# Autodesk Inventor assembly: SPE5V1 Guia Detectores
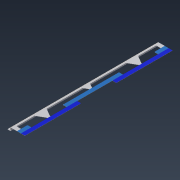
[picture p0: Inventor's stored thumbnail of the model, 180x180]
Saved by Autodesk Inventor 2021.2 (Build 252289000, 289)
## iProperties
Created: 2026-10-13
Part Number: SPE5V1 Guia Detectores
Document SubType Name: Assembly
Designer: nelso
Author: nelso
## Documents named in this file (6)
- C:\Users\Tecnica\OneDrive\Documentos\Mecanica\Soporte-Paciente-Espinografia\Workspace\SPE5V1 Guia Detectores.iam
- C:\Users\Tecnica\OneDrive\Documentos\Mecanica\Soporte-Paciente-Espinografia\Workspace\SP50V1 Chapa Detectores.ipt
- C:\Users\Tecnica\OneDrive\Documentos\Mecanica\Soporte-Paciente-Espinografia\Workspace\SP51V1 Felpa Detectores.ipt
- C:\Users\Tecnica\OneDrive\Documentos\Mecanica\Soporte-Paciente-Espinografia\Workspace\PinturaDetectores.ipt
- C:\Users\Tecnica\OneDrive\Documentos\Mecanica\Soporte-Paciente-Espinografia\Workspace\E1018NEO.ipt
- C:\Users\Tecnica\OneDrive\Documentos\Mecanica\Soporte-Paciente-Espinografia\Workspace\ISO7380M3X0.5L6I.ipt
## Components (9 placed, 5 different names)
1. SP50V1 Chapa Detectores:1 — Mate:1, Flush:1, Flush:2, Mate:2, Mate:3, Mate:4, Flush:6, Mate:6, Mate:7, Mate:8, Mate:9, Mate:10, Mate:11, Mate:12, Mate:13, Mate:14, Mate:15, Mate:16, Mate:17, Mate:18
2. SP51V1 Felpa Detectores:1 — Mate:2, Mate:3, Mate:4
3. PinturaDetectores:1 — Mate:1, Flush:1, Flush:2
4. E1018NEO:1 — Mate:7, Mate:12
5. E1018NEO:2 — Mate:8, Mate:11
6. E1018NEO:3 — Mate:9, Mate:10
7. ISO7380M3X0.5L6I:1 — Mate:13, Mate:14
8. ISO7380M3X0.5L6I:2 — Mate:15, Mate:16
9. ISO7380M3X0.5L6I:3 — Mate:17, Mate:18
## Relationships (20: Mate 17, Flush 3)
- Mate:1: SP50V1 Chapa Detectores:1 ↔ PinturaDetectores:1
- Flush:1: SP50V1 Chapa Detectores:1 ↔ PinturaDetectores:1
- Flush:2: SP50V1 Chapa Detectores:1 ↔ PinturaDetectores:1
- Mate:2: SP50V1 Chapa Detectores:1 ↔ SP51V1 Felpa Detectores:1
- Mate:3: SP50V1 Chapa Detectores:1 ↔ SP51V1 Felpa Detectores:1
- Mate:4 (7 mm): SP50V1 Chapa Detectores:1 ↔ SP51V1 Felpa Detectores:1
- Flush:6: SP50V1 Chapa Detectores:1
- Mate:6: SP50V1 Chapa Detectores:1
- Mate:7: SP50V1 Chapa Detectores:1 ↔ E1018NEO:1
- Mate:8: SP50V1 Chapa Detectores:1 ↔ E1018NEO:2
- Mate:9: SP50V1 Chapa Detectores:1 ↔ E1018NEO:3
- Mate:10: SP50V1 Chapa Detectores:1 ↔ E1018NEO:3
- Mate:11: SP50V1 Chapa Detectores:1 ↔ E1018NEO:2
- Mate:12: SP50V1 Chapa Detectores:1 ↔ E1018NEO:1
- Mate:13: SP50V1 Chapa Detectores:1 ↔ ISO7380M3X0.5L6I:1
- Mate:14: SP50V1 Chapa Detectores:1 ↔ ISO7380M3X0.5L6I:1
- Mate:15: SP50V1 Chapa Detectores:1 ↔ ISO7380M3X0.5L6I:2
- Mate:16: SP50V1 Chapa Detectores:1 ↔ ISO7380M3X0.5L6I:2
- Mate:17: SP50V1 Chapa Detectores:1 ↔ ISO7380M3X0.5L6I:3
- Mate:18: SP50V1 Chapa Detectores:1 ↔ ISO7380M3X0.5L6I:3
